(part 1 of 2)
# Autodesk Inventor assembly: Ensemble11
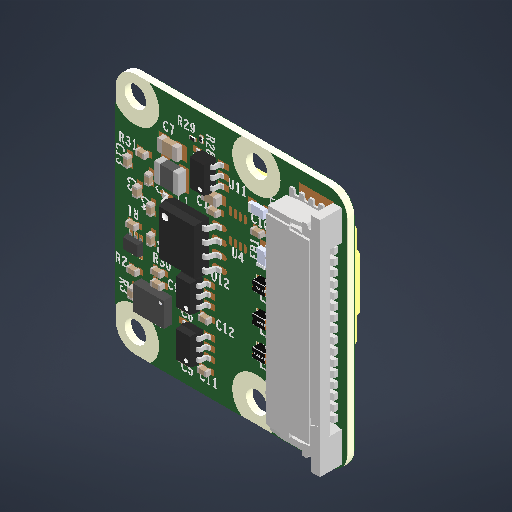
[picture p0: Inventor's stored thumbnail of the model, 512x512]
Saved by Autodesk Inventor 2026.2 (Build 302298010, 298A)
## iProperties
Created: 2026-11-11
Part Number: Ensemble11
Document SubType Name: Assembly
Designer: User
Author: User
## iProperties of the stored document RESC1005X40N_3.ipt
Created: 2026-11-11
Part Number: RESC1005X40N
Material: Générique
Description: PART--DESC
Document SubType Name: Modeling
Designer: User
Density: 1 g/cm^3
Appearance: Par défaut
Author: User
Revision Number: NONE
## iProperties of the stored document SOT95P280X145-5N_1.ipt
Created: 2026-11-11
Part Number: SOT95P280X145-5N
Material: Générique
Description: PART--DESC
Document SubType Name: Modeling
Designer: User
Density: 1 g/cm^3
Appearance: Par défaut
Author: User
Revision Number: NONE
## iProperties of the stored document MURATA_DLP11SNXXXHL2.ipt
Created: 2026-11-11
Part Number: MURATA_DLP11SNXXXHL2
Material: Générique
Description: PART--DESC
Document SubType Name: Modeling
Designer: User
Density: 1 g/cm^3
Appearance: Par défaut
Author: User
Revision Number: NONE
## iProperties of the stored document S2_1.ipt
Created: 2026-11-11
Part Number: S2
Material: Générique
Description: PART--DESC
Document SubType Name: Modeling
Designer: User
Density: 1 g/cm^3
Appearance: Par défaut
Author: User
Revision Number: NONE
## iProperties of the stored document NC1.ipt
Created: 2026-11-11
Part Number: NC1
Material: Générique
Description: PART--DESC
Document SubType Name: Modeling
Designer: User
Density: 1 g/cm^3
Appearance: Par défaut
Author: User
Revision Number: NONE
## iProperties of the stored document MECHANICAL PIN.ipt
Created: 2026-11-11
Part Number: MECHANICAL PIN
Material: Générique
Description: PART--DESC
Document SubType Name: Modeling
Designer: User
Density: 1 g/cm^3
Appearance: Par défaut
Author: User
Revision Number: NONE
## iProperties of the stored document 2_22.ipt
Created: 2026-11-11
Part Number: 2
Material: Générique
Description: PART--DESC
Document SubType Name: Modeling
Designer: User
Density: 1 g/cm^3
Appearance: Par défaut
Author: User
Revision Number: NONE
## iProperties of the stored document AFVDD.ipt
Created: 2026-11-11
Part Number: AFVDD
Material: Générique
Description: PART--DESC
Document SubType Name: Modeling
Designer: User
Density: 1 g/cm^3
Appearance: Par défaut
Author: User
Revision Number: NONE
## iProperties of the stored document 2_17.ipt
Created: 2026-11-11
Part Number: 2
Material: Générique
Description: PART--DESC
Document SubType Name: Modeling
Designer: User
Density: 1 g/cm^3
Appearance: Par défaut
Author: User
Revision Number: NONE
## iProperties of the stored document CAPC2012.ipt
Created: 2026-11-11
Part Number: CAPC2012
Material: Générique
Description: PART--DESC
Document SubType Name: Modeling
Designer: User
Density: 1 g/cm^3
Appearance: Par défaut
Author: User
Revision Number: NONE
## iProperties of the stored document 1_16.ipt
Created: 2026-11-11
Part Number: 1
Material: Générique
Description: PART--DESC
Document SubType Name: Modeling
Designer: User
Density: 1 g/cm^3
Appearance: Par défaut
Author: User
Revision Number: NONE
## iProperties of the stored document CAPC1005X55N.ipt
Created: 2026-11-11
Part Number: CAPC1005X55N
Material: Générique
Description: PART--DESC
Document SubType Name: Modeling
Designer: User
Density: 1 g/cm^3
Appearance: Par défaut
Author: User
Revision Number: NONE
## iProperties of the stored document 1_4.ipt
Created: 2026-11-11
Part Number: 1
Material: Générique
Description: PART--DESC
Document SubType Name: Modeling
Designer: User
Density: 1 g/cm^3
Appearance: Par défaut
Author: User
Revision Number: NONE
## iProperties of the stored document 1_10.ipt
Created: 2026-11-11
Part Number: 1
Material: Générique
Description: PART--DESC
Document SubType Name: Modeling
Designer: User
Density: 1 g/cm^3
Appearance: Par défaut
Author: User
Revision Number: NONE
## iProperties of the stored document 2.ipt
Created: 2026-11-11
Part Number: 2
Material: Générique
Description: PART--DESC
Document SubType Name: Modeling
Designer: User
Density: 1 g/cm^3
Appearance: Par défaut
Author: User
Revision Number: NONE
## iProperties of the stored document NC1_1.ipt
Created: 2026-11-11
Part Number: NC1
Material: Générique
Description: PART--DESC
Document SubType Name: Modeling
Designer: User
Density: 1 g/cm^3
Appearance: Par défaut
Author: User
Revision Number: NONE
## iProperties of the stored document NC2.ipt
Created: 2026-11-11
Part Number: NC2
Material: Générique
Description: PART--DESC
Document SubType Name: Modeling
Designer: User
Density: 1 g/cm^3
Appearance: Par défaut
Author: User
Revision Number: NONE
## iProperties of the stored document 15.ipt
Created: 2026-11-11
Part Number: 15
Material: Générique
Description: PART--DESC
Document SubType Name: Modeling
Designer: User
Density: 1 g/cm^3
Appearance: Par défaut
Author: User
Revision Number: NONE
## iProperties of the stored document 1_3.ipt
Created: 2026-11-11
Part Number: 1
Material: Générique
Description: PART--DESC
Document SubType Name: Modeling
Designer: User
Density: 1 g/cm^3
Appearance: Par défaut
Author: User
Revision Number: NONE
## iProperties of the stored document CAPC1608X90N.ipt
Created: 2026-11-11
Part Number: CAPC1608X90N
Material: Générique
Description: PART--DESC
Document SubType Name: Modeling
Designer: User
Density: 1 g/cm^3
Appearance: Par défaut
Author: User
Revision Number: NONE
## iProperties of the stored document CAPC1005X55N_4.ipt
Created: 2026-11-11
Part Number: CAPC1005X55N
Material: Générique
Description: PART--DESC
Document SubType Name: Modeling
Designer: User
Density: 1 g/cm^3
Appearance: Par défaut
Author: User
Revision Number: NONE
## iProperties of the stored document 1_5.ipt
Created: 2026-11-11
Part Number: 1
Material: Générique
Description: PART--DESC
Document SubType Name: Modeling
Designer: User
Density: 1 g/cm^3
Appearance: Par défaut
Author: User
Revision Number: NONE
## iProperties of the stored document MD1N.ipt
Created: 2026-11-11
Part Number: MD1N
Material: Générique
Description: PART--DESC
Document SubType Name: Modeling
Designer: User
Density: 1 g/cm^3
Appearance: Par défaut
Author: User
Revision Number: NONE
## iProperties of the stored document NC2_2.ipt
Created: 2026-11-11
Part Number: NC2
Material: Générique
Description: PART--DESC
Document SubType Name: Modeling
Designer: User
Density: 1 g/cm^3
Appearance: Par défaut
Author: User
Revision Number: NONE
## iProperties of the stored document P3.ipt
Created: 2026-11-11
Part Number: P3
Material: Générique
Description: PART--DESC
Document SubType Name: Modeling
Designer: User
Density: 1 g/cm^3
Appearance: Par défaut
Author: User
Revision Number: NONE
## iProperties of the stored document GND_2.ipt
Created: 2026-11-11
Part Number: GND
Material: Générique
Description: PART--DESC
Document SubType Name: Modeling
Designer: User
Density: 1 g/cm^3
Appearance: Par défaut
Author: User
Revision Number: NONE
## iProperties of the stored document DGND8.ipt
Created: 2026-11-11
Part Number: DGND8
Material: Générique
Description: PART--DESC
Document SubType Name: Modeling
Designer: User
Density: 1 g/cm^3
Appearance: Par défaut
Author: User
Revision Number: NONE
## iProperties of the stored document 2_1.ipt
Created: 2026-11-11
Part Number: 2
Material: Générique
Description: PART--DESC
Document SubType Name: Modeling
Designer: User
Density: 1 g/cm^3
Appearance: Par défaut
Author: User
Revision Number: NONE
## iProperties of the stored document 1_24.ipt
Created: 2026-11-11
Part Number: 1
Material: Générique
Description: PART--DESC
Document SubType Name: Modeling
Designer: User
Density: 1 g/cm^3
Appearance: Par défaut
Author: User
Revision Number: NONE
## iProperties of the stored document P1.ipt
Created: 2026-11-11
Part Number: P1
Material: Générique
Description: PART--DESC
Document SubType Name: Modeling
Designer: User
Density: 1 g/cm^3
Appearance: Par défaut
Author: User
Revision Number: NONE
## iProperties of the stored document DVDD_GPIO.ipt
Created: 2026-11-11
Part Number: DVDD/GPIO
Material: Générique
Description: PART--DESC
Document SubType Name: Modeling
Designer: User
Density: 1 g/cm^3
Appearance: Par défaut
Author: User
Revision Number: NONE
## iProperties of the stored document VCC.ipt
Created: 2026-11-11
Part Number: VCC
Material: Générique
Description: PART--DESC
Document SubType Name: Modeling
Designer: User
Density: 1 g/cm^3
Appearance: Par défaut
Author: User
Revision Number: NONE
## iProperties of the stored document EXP_PAD.ipt
Created: 2026-11-11
Part Number: EXP_PAD
Material: Générique
Description: PART--DESC
Document SubType Name: Modeling
Designer: User
Density: 1 g/cm^3
Appearance: Par défaut
Author: User
Revision Number: NONE
## iProperties of the stored document PG.ipt
Created: 2026-11-11
Part Number: PG
Material: Générique
Description: PART--DESC
Document SubType Name: Modeling
Designer: User
Density: 1 g/cm^3
Appearance: Par défaut
Author: User
Revision Number: NONE
## iProperties of the stored document VDD.ipt
Created: 2026-11-11
Part Number: VDD
Material: Générique
Description: PART--DESC
Document SubType Name: Modeling
Designer: User
Density: 1 g/cm^3
Appearance: Par défaut
Author: User
Revision Number: NONE
## iProperties of the stored document G2_1.ipt
Created: 2026-11-11
Part Number: G2
Material: Générique
Description: PART--DESC
Document SubType Name: Modeling
Designer: User
Density: 1 g/cm^3
Appearance: Par défaut
Author: User
Revision Number: NONE
## iProperties of the stored document GND_1.ipt
Created: 2026-11-11
Part Number: GND
Material: Générique
Description: PART--DESC
Document SubType Name: Modeling
Designer: User
Density: 1 g/cm^3
Appearance: Par défaut
Author: User
Revision Number: NONE
## iProperties of the stored document 12.ipt
Created: 2026-11-11
Part Number: 12
Material: Générique
Description: PART--DESC
Document SubType Name: Modeling
Designer: User
Density: 1 g/cm^3
Appearance: Par défaut
Author: User
Revision Number: NONE
## iProperties of the stored document CAPC1608X90N_1.ipt
Created: 2026-11-11
Part Number: CAPC1608X90N
Material: Générique
Description: PART--DESC
Document SubType Name: Modeling
Designer: User
Density: 1 g/cm^3
Appearance: Par défaut
Author: User
Revision Number: NONE
## iProperties of the stored document RESC1005X40N_4.ipt
Created: 2026-11-11
Part Number: RESC1005X40N
Material: Générique
Description: PART--DESC
Document SubType Name: Modeling
Designer: User
Density: 1 g/cm^3
Appearance: Par défaut
Author: User
Revision Number: NONE
## iProperties of the stored document 2_5.ipt
Created: 2026-11-11
Part Number: 2
Material: Générique
Description: PART--DESC
Document SubType Name: Modeling
Designer: User
Density: 1 g/cm^3
Appearance: Par défaut
Author: User
Revision Number: NONE
## iProperties of the stored document 1_22.ipt
Created: 2026-11-11
Part Number: 1
Material: Générique
Description: PART--DESC
Document SubType Name: Modeling
Designer: User
Density: 1 g/cm^3
Appearance: Par défaut
Author: User
Revision Number: NONE
## iProperties of the stored document G2.ipt
Created: 2026-11-11
Part Number: G2
Material: Générique
Description: PART--DESC
Document SubType Name: Modeling
Designer: User
Density: 1 g/cm^3
Appearance: Par défaut
Author: User
Revision Number: NONE
## iProperties of the stored document ATMEL_ATSHA204A_SOIC8.ipt
Created: 2026-11-11
Part Number: ATMEL_ATSHA204A_SOIC8
Material: Générique
Description: PART--DESC
Document SubType Name: Modeling
Designer: User
Density: 1 g/cm^3
Appearance: Par défaut
Author: User
Revision Number: NONE
## iProperties of the stored document MD1P.ipt
Created: 2026-11-11
Part Number: MD1P
Material: Générique
Description: PART--DESC
Document SubType Name: Modeling
Designer: User
Density: 1 g/cm^3
Appearance: Par défaut
Author: User
Revision Number: NONE
## iProperties of the stored document SCL.ipt
Created: 2026-11-11
Part Number: SCL
Material: Générique
Description: PART--DESC
Document SubType Name: Modeling
Designer: User
Density: 1 g/cm^3
Appearance: Par défaut
Author: User
Revision Number: NONE
## iProperties of the stored document 2_21.ipt
Created: 2026-11-11
Part Number: 2
Material: Générique
Description: PART--DESC
Document SubType Name: Modeling
Designer: User
Density: 1 g/cm^3
Appearance: Par défaut
Author: User
Revision Number: NONE
## iProperties of the stored document CAPC1005X55N_1.ipt
Created: 2026-11-11
Part Number: CAPC1005X55N
Material: Générique
Description: PART--DESC
Document SubType Name: Modeling
Designer: User
Density: 1 g/cm^3
Appearance: Par défaut
Author: User
Revision Number: NONE
## iProperties of the stored document SDA.ipt
Created: 2026-11-11
Part Number: SDA
Material: Générique
Description: PART--DESC
Document SubType Name: Modeling
Designer: User
Density: 1 g/cm^3
Appearance: Par défaut
Author: User
Revision Number: NONE
## iProperties of the stored document 1_7.ipt
Created: 2026-11-11
Part Number: 1
Material: Générique
Description: PART--DESC
Document SubType Name: Modeling
Designer: User
Density: 1 g/cm^3
Appearance: Par défaut
Author: User
Revision Number: NONE
## iProperties of the stored document 1_14.ipt
Created: 2026-11-11
Part Number: 1
Material: Générique
Description: PART--DESC
Document SubType Name: Modeling
Designer: User
Density: 1 g/cm^3
Appearance: Par défaut
Author: User
Revision Number: NONE
## iProperties of the stored document 2_23.ipt
Created: 2026-11-11
Part Number: 2
Material: Générique
Description: PART--DESC
Document SubType Name: Modeling
Designer: User
Density: 1 g/cm^3
Appearance: Par défaut
Author: User
Revision Number: NONE
## iProperties of the stored document 2_3.ipt
Created: 2026-11-11
Part Number: 2
Material: Générique
Description: PART--DESC
Document SubType Name: Modeling
Designer: User
Density: 1 g/cm^3
Appearance: Par défaut
Author: User
Revision Number: NONE
## iProperties of the stored document 1.ipt
Created: 2026-11-11
Part Number: 1
Material: Générique
Description: PART--DESC
Document SubType Name: Modeling
Designer: User
Density: 1 g/cm^3
Appearance: Par défaut
Author: User
Revision Number: NONE
## iProperties of the stored document LX.ipt
Created: 2026-11-11
Part Number: LX
Material: Générique
Description: PART--DESC
Document SubType Name: Modeling
Designer: User
Density: 1 g/cm^3
Appearance: Par défaut
Author: User
Revision Number: NONE
## iProperties of the stored document P4_2.ipt
Created: 2026-11-11
Part Number: P4
Material: Générique
Description: PART--DESC
Document SubType Name: Modeling
Designer: User
Density: 1 g/cm^3
Appearance: Par défaut
Author: User
Revision Number: NONE
## iProperties of the stored document 8.ipt
Created: 2026-11-11
Part Number: 8
Material: Générique
Description: PART--DESC
Document SubType Name: Modeling
Designer: User
Density: 1 g/cm^3
Appearance: Par défaut
Author: User
Revision Number: NONE
## iProperties of the stored document MCKP.ipt
Created: 2026-11-11
Part Number: MCKP
Material: Générique
Description: PART--DESC
Document SubType Name: Modeling
Designer: User
Density: 1 g/cm^3
Appearance: Par défaut
Author: User
Revision Number: NONE
## iProperties of the stored document DVDD.ipt
Created: 2026-11-11
Part Number: DVDD
Material: Générique
Description: PART--DESC
Document SubType Name: Modeling
Designer: User
Density: 1 g/cm^3
Appearance: Par défaut
Author: User
Revision Number: NONE
## iProperties of the stored document VO1V8.ipt
Created: 2026-11-11
Part Number: VO1V8
Material: Générique
Description: PART--DESC
Document SubType Name: Modeling
Designer: User
Density: 1 g/cm^3
Appearance: Par défaut
Author: User
Revision Number: NONE
## iProperties of the stored document ATMEL_ATSHA204A_8UDFN.ipt
Created: 2026-11-11
Part Number: ATMEL_ATSHA204A_8UDFN
Material: Générique
Description: PART--DESC
Document SubType Name: Modeling
Designer: User
Density: 1 g/cm^3
Appearance: Par défaut
Author: User
Revision Number: NONE
## iProperties of the stored document DGND3.ipt
Created: 2026-11-11
Part Number: DGND3
Material: Générique
Description: PART--DESC
Document SubType Name: Modeling
Designer: User
Density: 1 g/cm^3
Appearance: Par défaut
Author: User
Revision Number: NONE
## iProperties of the stored document 7.ipt
Created: 2026-11-11
Part Number: 7
Material: Générique
Description: PART--DESC
Document SubType Name: Modeling
Designer: User
Density: 1 g/cm^3
Appearance: Par défaut
Author: User
Revision Number: NONE
## iProperties of the stored document D2_1.ipt
Created: 2026-11-11
Part Number: D2
Material: Générique
Description: PART--DESC
Document SubType Name: Modeling
Designer: User
Density: 1 g/cm^3
Appearance: Par défaut
Author: User
Revision Number: NONE
## iProperties of the stored document 1_2.ipt
Created: 2026-11-11
Part Number: 1
Material: Générique
Description: PART--DESC
Document SubType Name: Modeling
Designer: User
Density: 1 g/cm^3
Appearance: Par défaut
Author: User
Revision Number: NONE
## iProperties of the stored document _PWDN.ipt
Created: 2026-11-11
Part Number: /PWDN
Material: Générique
Description: PART-/PWDN-DESC
Document SubType Name: Modeling
Designer: User
Density: 1 g/cm^3
Appearance: Par défaut
Author: User
Revision Number: NONE
## iProperties of the stored document 1_1.ipt
Created: 2026-11-11
Part Number: 1
Material: Générique
Description: PART--DESC
Document SubType Name: Modeling
Designer: User
Density: 1 g/cm^3
Appearance: Par défaut
Author: User
Revision Number: NONE
## iProperties of the stored document OUTPUT.ipt
Created: 2026-11-11
Part Number: OUTPUT
Material: Générique
Description: PART--DESC
Document SubType Name: Modeling
Designer: User
Density: 1 g/cm^3
Appearance: Par défaut
Author: User
Revision Number: NONE
## iProperties of the stored document CAPC1005X55N_2.ipt
Created: 2026-11-11
Part Number: CAPC1005X55N
Material: Générique
Description: PART--DESC
Document SubType Name: Modeling
Designer: User
Density: 1 g/cm^3
Appearance: Par défaut
Author: User
Revision Number: NONE
## iProperties of the stored document CAPC1005X55N_5.ipt
Created: 2026-11-11
Part Number: CAPC1005X55N
Material: Générique
Description: PART--DESC
Document SubType Name: Modeling
Designer: User
Density: 1 g/cm^3
Appearance: Par défaut
Author: User
Revision Number: NONE
## iProperties of the stored document EN_1.ipt
Created: 2026-11-11
Part Number: EN
Material: Générique
Description: PART--DESC
Document SubType Name: Modeling
Designer: User
Density: 1 g/cm^3
Appearance: Par défaut
Author: User
Revision Number: NONE
## iProperties of the stored document 2_9.ipt
Created: 2026-11-11
Part Number: 2
Material: Générique
Description: PART--DESC
Document SubType Name: Modeling
Designer: User
Density: 1 g/cm^3
Appearance: Par défaut
Author: User
Revision Number: NONE
## iProperties of the stored document OE.ipt
Created: 2026-11-11
Part Number: OE
Material: Générique
Description: PART--DESC
Document SubType Name: Modeling
Designer: User
Density: 1 g/cm^3
Appearance: Par défaut
Author: User
Revision Number: NONE
## iProperties of the stored document MURATA_DLP11SNXXXHL2_2.ipt
Created: 2026-11-11
Part Number: MURATA_DLP11SNXXXHL2
Material: Générique
Description: PART--DESC
Document SubType Name: Modeling
Designer: User
Density: 1 g/cm^3
Appearance: Par défaut
Author: User
Revision Number: NONE
## iProperties of the stored document P2.ipt
Created: 2026-11-11
Part Number: P2
Material: Générique
Description: PART--DESC
Document SubType Name: Modeling
Designer: User
Density: 1 g/cm^3
Appearance: Par défaut
Author: User
Revision Number: NONE
## iProperties of the stored document NC2_1.ipt
Created: 2026-11-11
Part Number: NC2
Material: Générique
Description: PART--DESC
Document SubType Name: Modeling
Designer: User
Density: 1 g/cm^3
Appearance: Par défaut
Author: User
Revision Number: NONE
## iProperties of the stored document Shapes.iam
Created: 2026-11-11
Part Number: Shapes
Description: PART--DESC
Document SubType Name: Assembly
Designer: User
Author: User
Revision Number: NONE
## iProperties of the stored document GND_6.ipt
Created: 2026-11-11
Part Number: GND
Material: Générique
Description: PART--DESC
Document SubType Name: Modeling
Designer: User
Density: 1 g/cm^3
Appearance: Par défaut
Author: User
Revision Number: NONE
## iProperties of the stored document RESC1005X40N_1.ipt
Created: 2026-11-11
Part Number: RESC1005X40N
Material: Générique
Description: PART--DESC
Document SubType Name: Modeling
Designer: User
Density: 1 g/cm^3
Appearance: Par défaut
Author: User
Revision Number: NONE
## iProperties of the stored document P4.ipt
Created: 2026-11-11
Part Number: P4
Material: Générique
Description: PART--DESC
Document SubType Name: Modeling
Designer: User
Density: 1 g/cm^3
Appearance: Par défaut
Author: User
Revision Number: NONE
## iProperties of the stored document NC3.ipt
Created: 2026-11-11
Part Number: NC3
Material: Générique
Description: PART--DESC
Document SubType Name: Modeling
Designer: User
Density: 1 g/cm^3
Appearance: Par défaut
Author: User
Revision Number: NONE
## iProperties of the stored document MECHANICAL PIN_2.ipt
Created: 2026-11-11
Part Number: MECHANICAL PIN
Material: Générique
Description: PART--DESC
Document SubType Name: Modeling
Designer: User
Density: 1 g/cm^3
Appearance: Par défaut
Author: User
Revision Number: NONE
## iProperties of the stored document NC6.ipt
Created: 2026-11-11
Part Number: NC6
Material: Générique
Description: PART--DESC
Document SubType Name: Modeling
Designer: User
Density: 1 g/cm^3
Appearance: Par défaut
Author: User
Revision Number: NONE
## iProperties of the stored document GND_3.ipt
Created: 2026-11-11
Part Number: GND
Material: Générique
Description: PART--DESC
Document SubType Name: Modeling
Designer: User
Density: 1 g/cm^3
Appearance: Par défaut
Author: User
Revision Number: NONE
## iProperties of the stored document DGND6.ipt
Created: 2026-11-11
Part Number: DGND6
Material: Générique
Description: PART--DESC
Document SubType Name: Modeling
Designer: User
Density: 1 g/cm^3
Appearance: Par défaut
Author: User
Revision Number: NONE
## iProperties of the stored document SILKSCREEN_BOTTOM.ipt
Created: 2026-11-11
Part Number: SILKSCREEN_BOTTOM
Material: Générique
Description: PART--DESC
Document SubType Name: Modeling
Designer: User
Density: 1 g/cm^3
Appearance: Par défaut
Author: User
Revision Number: NONE
## iProperties of the stored document P4_1.ipt
Created: 2026-11-11
Part Number: P4
Material: Générique
Description: PART--DESC
Document SubType Name: Modeling
Designer: User
Density: 1 g/cm^3
Appearance: Par défaut
Author: User
Revision Number: NONE
## iProperties of the stored document 2_14.ipt
Created: 2026-11-11
Part Number: 2
Material: Générique
Description: PART--DESC
Document SubType Name: Modeling
Designer: User
Density: 1 g/cm^3
Appearance: Par défaut
Author: User
Revision Number: NONE
## iProperties of the stored document FCI_SFW15R-1STE1LF.ipt
Created: 2026-11-11
Part Number: FCI_SFW15R-1STE1LF
Material: Générique
Description: PART--DESC
Document SubType Name: Modeling
Designer: User
Density: 1 g/cm^3
Appearance: Par défaut
Author: User
Revision Number: NONE
## iProperties of the stored document 1_23.ipt
Created: 2026-11-11
Part Number: 1
Material: Générique
Description: PART--DESC
Document SubType Name: Modeling
Designer: User
Density: 1 g/cm^3
Appearance: Par défaut
Author: User
Revision Number: NONE
## iProperties of the stored document P3_2.ipt
Created: 2026-11-11
Part Number: P3
Material: Générique
Description: PART--DESC
Document SubType Name: Modeling
Designer: User
Density: 1 g/cm^3
Appearance: Par défaut
Author: User
Revision Number: NONE
## iProperties of the stored document CAPC1005X55N_8.ipt
Created: 2026-11-11
Part Number: CAPC1005X55N
Material: Générique
Description: PART--DESC
Document SubType Name: Modeling
Designer: User
Density: 1 g/cm^3
Appearance: Par défaut
Author: User
Revision Number: NONE
## iProperties of the stored document CAPC1608.ipt
Created: 2026-11-11
Part Number: CAPC1608
Material: Générique
Description: PART--DESC
Document SubType Name: Modeling
Designer: User
Density: 1 g/cm^3
Appearance: Par défaut
Author: User
Revision Number: NONE
## iProperties of the stored document 5.ipt
Created: 2026-11-11
Part Number: 5
Material: Générique
Description: PART--DESC
Document SubType Name: Modeling
Designer: User
Density: 1 g/cm^3
Appearance: Par défaut
Author: User
Revision Number: NONE
## iProperties of the stored document RESC0603.ipt
Created: 2026-11-11
Part Number: RESC0603
Material: Générique
Description: PART--DESC
Document SubType Name: Modeling
Designer: User
Density: 1 g/cm^3
Appearance: Par défaut
Author: User
Revision Number: NONE
## iProperties of the stored document GND_5.ipt
Created: 2026-11-11
Part Number: GND
Material: Générique
Description: PART--DESC
Document SubType Name: Modeling
Designer: User
Density: 1 g/cm^3
Appearance: Par défaut
Author: User
Revision Number: NONE
## iProperties of the stored document 1_15.ipt
Created: 2026-11-11
Part Number: 1
Material: Générique
Description: PART--DESC
Document SubType Name: Modeling
Designer: User
Density: 1 g/cm^3
Appearance: Par défaut
Author: User
Revision Number: NONE
## iProperties of the stored document Pins.iam
Created: 2026-11-11
Part Number: Pins
Description: PART--DESC
Document SubType Name: Assembly
Designer: User
Author: User
Revision Number: NONE
## iProperties of the stored document 2_16.ipt
Created: 2026-11-11
Part Number: 2
Material: Générique
Description: PART--DESC
Document SubType Name: Modeling
Designer: User
Density: 1 g/cm^3
Appearance: Par défaut
Author: User
Revision Number: NONE
## iProperties of the stored document 9.ipt
Created: 2026-11-11
Part Number: 9
Material: Générique
Description: PART--DESC
Document SubType Name: Modeling
Designer: User
Density: 1 g/cm^3
Appearance: Par défaut
Author: User
Revision Number: NONE
## iProperties of the stored document OUT_1.ipt
Created: 2026-11-11
Part Number: OUT
Material: Générique
Description: PART--DESC
Document SubType Name: Modeling
Designer: User
Density: 1 g/cm^3
Appearance: Par défaut
Author: User
Revision Number: NONE
## iProperties of the stored document 3.ipt
Created: 2026-11-11
Part Number: 3
Material: Générique
Description: PART--DESC
Document SubType Name: Modeling
Designer: User
Density: 1 g/cm^3
Appearance: Par défaut
Author: User
Revision Number: NONE
## iProperties of the stored document MECHANICAL PIN_1.ipt
Created: 2026-11-11
Part Number: MECHANICAL PIN
Material: Générique
Description: PART--DESC
Document SubType Name: Modeling
Designer: User
Density: 1 g/cm^3
Appearance: Par défaut
Author: User
Revision Number: NONE
## iProperties of the stored document 2_8.ipt
Created: 2026-11-11
Part Number: 2
Material: Générique
Description: PART--DESC
Document SubType Name: Modeling
Designer: User
Density: 1 g/cm^3
Appearance: Par défaut
Author: User
Revision Number: NONE
## iProperties of the stored document 2_2.ipt
Created: 2026-11-11
Part Number: 2
Material: Générique
Description: PART--DESC
Document SubType Name: Modeling
Designer: User
Density: 1 g/cm^3
Appearance: Par défaut
Author: User
Revision Number: NONE
## iProperties of the stored document 2_7.ipt
Created: 2026-11-11
Part Number: 2
Material: Générique
Description: PART--DESC
Document SubType Name: Modeling
Designer: User
Density: 1 g/cm^3
Appearance: Par défaut
Author: User
Revision Number: NONE
## iProperties of the stored document PASTEMASK_TOP.ipt
Created: 2026-11-11
Part Number: PASTEMASK_TOP
Material: Générique
Description: PART--DESC
Document SubType Name: Modeling
Designer: User
Density: 1 g/cm^3
Appearance: Par défaut
Author: User
Revision Number: NONE
## iProperties of the stored document NC7.ipt
Created: 2026-11-11
Part Number: NC7
Material: Générique
Description: PART--DESC
Document SubType Name: Modeling
Designer: User
Density: 1 g/cm^3
Appearance: Par défaut
Author: User
Revision Number: NONE
## iProperties of the stored document CAPC1005X55N_11.ipt
Created: 2026-11-11
Part Number: CAPC1005X55N
Material: Générique
Description: PART--DESC
Document SubType Name: Modeling
Designer: User
Density: 1 g/cm^3
Appearance: Par défaut
Author: User
Revision Number: NONE
## iProperties of the stored document GND.ipt
Created: 2026-11-11
Part Number: GND
Material: Générique
Description: PART--DESC
Document SubType Name: Modeling
Designer: User
Density: 1 g/cm^3
Appearance: Par défaut
Author: User
Revision Number: NONE
## iProperties of the stored document FB.ipt
Created: 2026-11-11
Part Number: FB
Material: Générique
Description: PART--DESC
Document SubType Name: Modeling
Designer: User
Density: 1 g/cm^3
Appearance: Par défaut
Author: User
Revision Number: NONE
## iProperties of the stored document 10.ipt
Created: 2026-11-11
Part Number: 10
Material: Générique
Description: PART--DESC
Document SubType Name: Modeling
Designer: User
Density: 1 g/cm^3
Appearance: Par défaut
Author: User
Revision Number: NONE
## iProperties of the stored document SOT50P160X60-6N.ipt
Created: 2026-11-11
Part Number: SOT50P160X60-6N
Material: Générique
Description: PART--DESC
Document SubType Name: Modeling
Designer: User
Density: 1 g/cm^3
Appearance: Par défaut
Author: User
Revision Number: NONE
## iProperties of the stored document BOURNS_SRN2512.ipt
Created: 2026-11-11
Part Number: BOURNS_SRN2512
Material: Générique
Description: PART--DESC
Document SubType Name: Modeling
Designer: User
Density: 1 g/cm^3
Appearance: Par défaut
Author: User
Revision Number: NONE
## iProperties of the stored document VIN.ipt
Created: 2026-11-11
Part Number: VIN
Material: Générique
Description: PART--DESC
Document SubType Name: Modeling
Designer: User
Density: 1 g/cm^3
Appearance: Par défaut
Author: User
Revision Number: NONE
## iProperties of the stored document PASTEMASK_BOTTOM.ipt
Created: 2026-11-11
Part Number: PASTEMASK_BOTTOM
Material: Générique
Description: PART--DESC
Document SubType Name: Modeling
Designer: User
Density: 1 g/cm^3
Appearance: Par défaut
Author: User
Revision Number: NONE
## iProperties of the stored document NC_1.ipt
Created: 2026-11-11
Part Number: NC
Material: Générique
Description: PART--DESC
Document SubType Name: Modeling
Designer: User
Density: 1 g/cm^3
Appearance: Par défaut
Author: User
Revision Number: NONE
## iProperties of the stored document 2_20.ipt
Created: 2026-11-11
Part Number: 2
Material: Générique
Description: PART--DESC
Document SubType Name: Modeling
Designer: User
Density: 1 g/cm^3
Appearance: Par défaut
Author: User
Revision Number: NONE
## iProperties of the stored document SCL_1.ipt
Created: 2026-11-11
Part Number: SCL
Material: Générique
Description: PART--DESC
Document SubType Name: Modeling
Designer: User
Density: 1 g/cm^3
Appearance: Par défaut
Author: User
Revision Number: NONE
## iProperties of the stored document DGND1.ipt
Created: 2026-11-11
Part Number: DGND1
Material: Générique
Description: PART--DESC
Document SubType Name: Modeling
Designer: User
Density: 1 g/cm^3
Appearance: Par défaut
Author: User
Revision Number: NONE
## iProperties of the stored document GND_4.ipt
Created: 2026-11-11
Part Number: GND
Material: Générique
Description: PART--DESC
Document SubType Name: Modeling
Designer: User
Density: 1 g/cm^3
Appearance: Par défaut
Author: User
Revision Number: NONE
## iProperties of the stored document CAPC1005X55N_10.ipt
Created: 2026-11-11
Part Number: CAPC1005X55N
Material: Générique
Description: PART--DESC
Document SubType Name: Modeling
Designer: User
Density: 1 g/cm^3
Appearance: Par défaut
Author: User
Revision Number: NONE
## iProperties of the stored document CAPC1005X55N_6.ipt
Created: 2026-11-11
Part Number: CAPC1005X55N
Material: Générique
Description: PART--DESC
Document SubType Name: Modeling
Designer: User
Density: 1 g/cm^3
Appearance: Par défaut
Author: User
Revision Number: NONE
## iProperties of the stored document VCC_1.ipt
Created: 2026-11-11
Part Number: VCC
Material: Générique
Description: PART--DESC
Document SubType Name: Modeling
Designer: User
Density: 1 g/cm^3
Appearance: Par défaut
Author: User
Revision Number: NONE
## iProperties of the stored document AGND.ipt
Created: 2026-11-11
Part Number: AGND
Material: Générique
Description: PART--DESC
Document SubType Name: Modeling
Designer: User
Density: 1 g/cm^3
Appearance: Par défaut
Author: User
Revision Number: NONE
## iProperties of the stored document MCLK.ipt
Created: 2026-11-11
Part Number: MCLK
Material: Générique
Description: PART--DESC
Document SubType Name: Modeling
Designer: User
Density: 1 g/cm^3
Appearance: Par défaut
Author: User
Revision Number: NONE
## iProperties of the stored document 1_17.ipt
Created: 2026-11-11
Part Number: 1
Material: Générique
Description: PART--DESC
Document SubType Name: Modeling
Designer: User
Density: 1 g/cm^3
Appearance: Par défaut
Author: User
Revision Number: NONE
## iProperties of the stored document P3_1.ipt
Created: 2026-11-11
Part Number: P3
Material: Générique
Description: PART--DESC
Document SubType Name: Modeling
Designer: User
Density: 1 g/cm^3
Appearance: Par défaut
Author: User
Revision Number: NONE
## iProperties of the stored document Symbols.iam
Created: 2026-11-11
Part Number: Symbols
Description: PART--DESC
Document SubType Name: Assembly
Designer: User
Author: User
Revision Number: NONE
## iProperties of the stored document EN_2.ipt
Created: 2026-11-11
Part Number: EN
Material: Générique
Description: PART--DESC
Document SubType Name: Modeling
Designer: User
Density: 1 g/cm^3
Appearance: Par défaut
Author: User
Revision Number: NONE
## iProperties of the stored document MD0P.ipt
Created: 2026-11-11
Part Number: MD0P
Material: Générique
Description: PART--DESC
Document SubType Name: Modeling
Designer: User
Density: 1 g/cm^3
Appearance: Par défaut
Author: User
Revision Number: NONE
## iProperties of the stored document CAPC1005X55N_3.ipt
Created: 2026-11-11
Part Number: CAPC1005X55N
Material: Générique
Description: PART--DESC
Document SubType Name: Modeling
Designer: User
Density: 1 g/cm^3
Appearance: Par défaut
Author: User
Revision Number: NONE
## iProperties of the stored document MECHANICAL PIN_4.ipt
Created: 2026-11-11
Part Number: MECHANICAL PIN
Material: Générique
Description: PART--DESC
Document SubType Name: Modeling
Designer: User
Density: 1 g/cm^3
Appearance: Par défaut
Author: User
Revision Number: NONE
## iProperties of the stored document MD0N.ipt
Created: 2026-11-11
Part Number: MD0N
Material: Générique
Description: PART--DESC
Document SubType Name: Modeling
Designer: User
Density: 1 g/cm^3
Appearance: Par défaut
Author: User
Revision Number: NONE
## iProperties of the stored document SOLDERMASK_TOP.ipt
Created: 2026-11-11
Part Number: SOLDERMASK_TOP
Material: Générique
Description: PART--DESC
Document SubType Name: Modeling
Designer: User
Density: 1 g/cm^3
Appearance: Par défaut
Author: User
Revision Number: NONE
## iProperties of the stored document 2_15.ipt
Created: 2026-11-11
Part Number: 2
Material: Générique
Description: PART--DESC
Document SubType Name: Modeling
Designer: User
Density: 1 g/cm^3
Appearance: Par défaut
Author: User
Revision Number: NONE
## iProperties of the stored document DGND7.ipt
Created: 2026-11-11
Part Number: DGND7
Material: Générique
Description: PART--DESC
Document SubType Name: Modeling
Designer: User
Density: 1 g/cm^3
Appearance: Par défaut
Author: User
Revision Number: NONE
## iProperties of the stored document 1_18.ipt
Created: 2026-11-11
Part Number: 1
Material: Générique
Description: PART--DESC
Document SubType Name: Modeling
Designer: User
Density: 1 g/cm^3
Appearance: Par défaut
Author: User
Revision Number: NONE
## iProperties of the stored document SILKSCREEN_TOP.ipt
Created: 2026-11-11
Part Number: SILKSCREEN_TOP
Material: Générique
Description: PART-SILKSCREEN_TOP-DESC
Document SubType Name: Modeling
Designer: User
Density: 1 g/cm^3
Appearance: Par défaut
Author: User
Revision Number: NONE
## iProperties of the stored document 1_12.ipt
Created: 2026-11-11
Part Number: 1
Material: Générique
Description: PART--DESC
Document SubType Name: Modeling
Designer: User
Density: 1 g/cm^3
Appearance: Par défaut
Author: User
Revision Number: NONE
## iProperties of the stored document RESC0603_1.ipt
Created: 2026-11-11
Part Number: RESC0603
Material: Générique
Description: PART--DESC
Document SubType Name: Modeling
Designer: User
Density: 1 g/cm^3
Appearance: Par défaut
Author: User
Revision Number: NONE
## iProperties of the stored document NC.ipt
Created: 2026-11-11
Part Number: NC
Material: Générique
Description: PART--DESC
Document SubType Name: Modeling
Designer: User
Density: 1 g/cm^3
Appearance: Par défaut
Author: User
Revision Number: NONE
## iProperties of the stored document VA2V8.ipt
Created: 2026-11-11
Part Number: VA2V8
Material: Générique
Description: PART--DESC
Document SubType Name: Modeling
Designer: User
Density: 1 g/cm^3
Appearance: Par défaut
Author: User
Revision Number: NONE
## iProperties of the stored document 2_6.ipt
Created: 2026-11-11
Part Number: 2
Material: Générique
Description: PART--DESC
Document SubType Name: Modeling
Designer: User
Density: 1 g/cm^3
Appearance: Par défaut
Author: User
Revision Number: NONE
## iProperties of the stored document 1_11.ipt
Created: 2026-11-11
Part Number: 1
Material: Générique
Description: PART--DESC
Document SubType Name: Modeling
Designer: User
Density: 1 g/cm^3
Appearance: Par défaut
Author: User
Revision Number: NONE
## iProperties of the stored document 4.ipt
Created: 2026-11-11
Part Number: 4
Material: Générique
Description: PART--DESC
Document SubType Name: Modeling
Designer: User
Density: 1 g/cm^3
Appearance: Par défaut
Author: User
Revision Number: NONE
## iProperties of the stored document SOLDERMASK_BOTTOM.ipt
Created: 2026-11-11
Part Number: SOLDERMASK_BOTTOM
Material: Générique
Description: PART--DESC
Document SubType Name: Modeling
Designer: User
Density: 1 g/cm^3
Appearance: Par défaut
Author: User
Revision Number: NONE
## iProperties of the stored document AP3445.ipt
Created: 2026-11-11
Part Number: AP3445
Material: Générique
Description: PART-AP3445-DESC
Document SubType Name: Modeling
Designer: User
Density: 1 g/cm^3
Appearance: Par défaut
Author: User
Revision Number: NONE
## iProperties of the stored document 2_10.ipt
Created: 2026-11-11
Part Number: 2
Material: Générique
Description: PART--DESC
Document SubType Name: Modeling
Designer: User
Density: 1 g/cm^3
Appearance: Par défaut
Author: User
Revision Number: NONE
## iProperties of the stored document 2_4.ipt
Created: 2026-11-11
Part Number: 2
Material: Générique
Description: PART--DESC
Document SubType Name: Modeling
Designer: User
Density: 1 g/cm^3
Appearance: Par défaut
Author: User
Revision Number: NONE
## iProperties of the stored document NC1_2.ipt
Created: 2026-11-11
Part Number: NC1
Material: Générique
Description: PART--DESC
Document SubType Name: Modeling
Designer: User
Density: 1 g/cm^3
Appearance: Par défaut
Author: User
Revision Number: NONE
## iProperties of the stored document HIROSE_DF37NC-30DS-04V.ipt
Created: 2026-11-11
Part Number: HIROSE_DF37NC-30DS-04V
Material: Générique
Description: PART--DESC
Document SubType Name: Modeling
Designer: User
Density: 1 g/cm^3
Appearance: Par défaut
Author: User
Revision Number: NONE
## iProperties of the stored document 2_13.ipt
Created: 2026-11-11
Part Number: 2
Material: Générique
Description: PART--DESC
Document SubType Name: Modeling
Designer: User
Density: 1 g/cm^3
Appearance: Par défaut
Author: User
Revision Number: NONE
## iProperties of the stored document 2_24.ipt
Created: 2026-11-11
Part Number: 2
Material: Générique
Description: PART--DESC
Document SubType Name: Modeling
Designer: User
Density: 1 g/cm^3
Appearance: Par défaut
Author: User
Revision Number: NONE
## iProperties of the stored document 6.ipt
Created: 2026-11-11
Part Number: 6
Material: Générique
Description: PART--DESC
Document SubType Name: Modeling
Designer: User
Density: 1 g/cm^3
Appearance: Par défaut
Author: User
Revision Number: NONE
## iProperties of the stored document DGND9.ipt
Created: 2026-11-11
Part Number: DGND9
Material: Générique
Description: PART--DESC
Document SubType Name: Modeling
Designer: User
Density: 1 g/cm^3
Appearance: Par défaut
Author: User
Revision Number: NONE
## iProperties of the stored document OSC_2P5X2MM.ipt
Created: 2026-11-11
Part Number: OSC_2P5X2MM
Material: Générique
Description: PART--DESC
Document SubType Name: Modeling
Designer: User
Density: 1 g/cm^3
Appearance: Par défaut
Author: User
Revision Number: NONE
## iProperties of the stored document RESC1005X40N_2.ipt
Created: 2026-11-11
Part Number: RESC1005X40N
Material: Générique
Description: PART--DESC
Document SubType Name: Modeling
Designer: User
Density: 1 g/cm^3
Appearance: Par défaut
Author: User
Revision Number: NONE
## iProperties of the stored document SOT95P280X145-5N.ipt
Created: 2026-11-11
Part Number: SOT95P280X145-5N
Material: Générique
Description: PART--DESC
Document SubType Name: Modeling
Designer: User
Density: 1 g/cm^3
Appearance: Par défaut
Author: User
Revision Number: NONE
## iProperties of the stored document SCL_2.ipt
Created: 2026-11-11
Part Number: SCL
Material: Générique
Description: PART--DESC
Document SubType Name: Modeling
Designer: User
Density: 1 g/cm^3
Appearance: Par défaut
Author: User
Revision Number: NONE
## iProperties of the stored document CAPC1005X55N_9.ipt
Created: 2026-11-11
Part Number: CAPC1005X55N
Material: Générique
Description: PART--DESC
Document SubType Name: Modeling
Designer: User
Density: 1 g/cm^3
Appearance: Par défaut
Author: User
Revision Number: NONE
## iProperties of the stored document 2_19.ipt
Created: 2026-11-11
Part Number: 2
Material: Générique
Description: PART--DESC
Document SubType Name: Modeling
Designer: User
Density: 1 g/cm^3
Appearance: Par défaut
Author: User
Revision Number: NONE
## iProperties of the stored document EN.ipt
Created: 2026-11-11
Part Number: EN
Material: Générique
Description: PART--DESC
Document SubType Name: Modeling
Designer: User
Density: 1 g/cm^3
Appearance: Par défaut
Author: User
Revision Number: NONE
## iProperties of the stored document 2_12.ipt
Created: 2026-11-11
Part Number: 2
Material: Générique
Description: PART--DESC
Document SubType Name: Modeling
Designer: User
Density: 1 g/cm^3
Appearance: Par défaut
Author: User
Revision Number: NONE
## iProperties of the stored document OUT.ipt
Created: 2026-11-11
Part Number: OUT
Material: Générique
Description: PART--DESC
Document SubType Name: Modeling
Designer: User
Density: 1 g/cm^3
Appearance: Par défaut
Author: User
Revision Number: NONE
## iProperties of the stored document DGND5.ipt
Created: 2026-11-11
Part Number: DGND5
Material: Générique
Description: PART--DESC
Document SubType Name: Modeling
Designer: User
Density: 1 g/cm^3
Appearance: Par défaut
Author: User
Revision Number: NONE
## iProperties of the stored document NC4.ipt
Created: 2026-11-11
Part Number: NC4
Material: Générique
Description: PART--DESC
Document SubType Name: Modeling
Designer: User
Density: 1 g/cm^3
Appearance: Par défaut
Author: User
Revision Number: NONE
## iProperties of the stored document 11.ipt
Created: 2026-11-11
Part Number: 11
Material: Générique
Description: PART--DESC
Document SubType Name: Modeling
Designer: User
Density: 1 g/cm^3
Appearance: Par défaut
Author: User
Revision Number: NONE
## iProperties of the stored document IN_1.ipt
Created: 2026-11-11
Part Number: IN
Material: Générique
Description: PART--DESC
Document SubType Name: Modeling
Designer: User
Density: 1 g/cm^3
Appearance: Par défaut
Author: User
Revision Number: NONE
## iProperties of the stored document CAPC1005X55N_7.ipt
Created: 2026-11-11
Part Number: CAPC1005X55N
Material: Générique
Description: PART--DESC
Document SubType Name: Modeling
Designer: User
Density: 1 g/cm^3
Appearance: Par défaut
Author: User
Revision Number: NONE
## iProperties of the stored document NC7_1.ipt
Created: 2026-11-11
Part Number: NC7
Material: Générique
Description: PART--DESC
Document SubType Name: Modeling
Designer: User
Density: 1 g/cm^3
Appearance: Par défaut
Author: User
Revision Number: NONE
## iProperties of the stored document S2.ipt
Created: 2026-11-11
Part Number: S2
Material: Générique
Description: PART--DESC
Document SubType Name: Modeling
Designer: User
Density: 1 g/cm^3
Appearance: Par défaut
Author: User
Revision Number: NONE
## iProperties of the stored document DGND4.ipt
Created: 2026-11-11
Part Number: DGND4
Material: Générique
Description: PART--DESC
Document SubType Name: Modeling
Designer: User
Density: 1 g/cm^3
Appearance: Par défaut
Author: User
Revision Number: NONE
## iProperties of the stored document 1_9.ipt
Created: 2026-11-11
Part Number: 1
Material: Générique
Description: PART--DESC
Document SubType Name: Modeling
Designer: User
Density: 1 g/cm^3
Appearance: Par défaut
Author: User
Revision Number: NONE
## iProperties of the stored document P1_1.ipt
Created: 2026-11-11
Part Number: P1
Material: Générique
Description: PART--DESC
Document SubType Name: Modeling
Designer: User
Density: 1 g/cm^3
Appearance: Par défaut
Author: User
Revision Number: NONE
## iProperties of the stored document MCKN.ipt
Created: 2026-11-11
Part Number: MCKN
Material: Générique
Description: PART--DESC
Document SubType Name: Modeling
Designer: User
Density: 1 g/cm^3
Appearance: Par défaut
Author: User
Revision Number: NONE
## iProperties of the stored document 13.ipt
Created: 2026-11-11
Part Number: 13
Material: Générique
Description: PART--DESC
Document SubType Name: Modeling
Designer: User
Density: 1 g/cm^3
Appearance: Par défaut
Author: User
Revision Number: NONE
## iProperties of the stored document RESC1005X40N.ipt
Created: 2026-11-11
Part Number: RESC1005X40N
Material: Générique
Description: PART--DESC
Document SubType Name: Modeling
Designer: User
Density: 1 g/cm^3
Appearance: Par défaut
Author: User
Revision Number: NONE
## iProperties of the stored document P2_2.ipt
Created: 2026-11-11
Part Number: P2
Material: Générique
Description: PART--DESC
Document SubType Name: Modeling
Designer: User
Density: 1 g/cm^3
Appearance: Par défaut
Author: User
Revision Number: NONE
## iProperties of the stored document NC3_1.ipt
Created: 2026-11-11
Part Number: NC3
Material: Générique
Description: PART--DESC
Document SubType Name: Modeling
Designer: User
Density: 1 g/cm^3
Appearance: Par défaut
Author: User
Revision Number: NONE
## iProperties of the stored document MURATA_DLP11SNXXXHL2_1.ipt
Created: 2026-11-11
Part Number: MURATA_DLP11SNXXXHL2
Material: Générique
Description: PART--DESC
Document SubType Name: Modeling
Designer: User
Density: 1 g/cm^3
Appearance: Par défaut
Author: User
Revision Number: NONE
## iProperties of the stored document Dielectric.ipt
Created: 2026-11-11
Part Number: Dielectric
Material: Générique
Description: PART--DESC
Document SubType Name: Modeling
Designer: User
Density: 1 g/cm^3
Appearance: Par défaut
Author: User
Revision Number: NONE
## iProperties of the stored document IN.ipt
Created: 2026-11-11
Part Number: IN
Material: Générique
Description: PART--DESC
Document SubType Name: Modeling
Designer: User
Density: 1 g/cm^3
Appearance: Par défaut
Author: User
Revision Number: NONE
## iProperties of the stored document 1_19.ipt
Created: 2026-11-11
Part Number: 1
Material: Générique
Description: PART--DESC
Document SubType Name: Modeling
Designer: User
Density: 1 g/cm^3
Appearance: Par défaut
Author: User
Revision Number: NONE
## iProperties of the stored document MECHANICAL PIN_5.ipt
Created: 2026-11-11
Part Number: MECHANICAL PIN
Material: Générique
Description: PART--DESC
Document SubType Name: Modeling
Designer: User
Density: 1 g/cm^3
Appearance: Par défaut
Author: User
Revision Number: NONE
## iProperties of the stored document 1_21.ipt
Created: 2026-11-11
Part Number: 1
Material: Générique
Description: PART--DESC
Document SubType Name: Modeling
Designer: User
Density: 1 g/cm^3
Appearance: Par défaut
Author: User
Revision Number: NONE
## iProperties of the stored document D2.ipt
Created: 2026-11-11
Part Number: D2
Material: Générique
Description: PART--DESC
Document SubType Name: Modeling
Designer: User
Density: 1 g/cm^3
Appearance: Par défaut
Author: User
Revision Number: NONE
## iProperties of the stored document MECHANICAL PIN_3.ipt
Created: 2026-11-11
Part Number: MECHANICAL PIN
Material: Générique
Description: PART--DESC
Document SubType Name: Modeling
Designer: User
Density: 1 g/cm^3
Appearance: Par défaut
Author: User
Revision Number: NONE
## iProperties of the stored document SDA_2.ipt
Created: 2026-11-11
Part Number: SDA
Material: Générique
Description: PART--DESC
Document SubType Name: Modeling
Designer: User
Density: 1 g/cm^3
Appearance: Par défaut
Author: User
Revision Number: NONE
## iProperties of the stored document SDA_1.ipt
Created: 2026-11-11
Part Number: SDA
Material: Générique
Description: PART--DESC
Document SubType Name: Modeling
Designer: User
Density: 1 g/cm^3
Appearance: Par défaut
Author: User
Revision Number: NONE
## iProperties of the stored document 14.ipt
Created: 2026-11-11
Part Number: 14
Material: Générique
Description: PART--DESC
Document SubType Name: Modeling
Designer: User
Density: 1 g/cm^3
Appearance: Par défaut
Author: User
Revision Number: NONE
## iProperties of the stored document 1_6.ipt
Created: 2026-11-11
Part Number: 1
Material: Générique
Description: PART--DESC
Document SubType Name: Modeling
Designer: User
Density: 1 g/cm^3
Appearance: Par défaut
Author: User
Revision Number: NONE
## iProperties of the stored document 2_18.ipt
Created: 2026-11-11
Part Number: 2
Material: Générique
Description: PART--DESC
Document SubType Name: Modeling
Designer: User
Density: 1 g/cm^3
Appearance: Par défaut
Author: User
Revision Number: NONE
## iProperties of the stored document 2_11.ipt
Created: 2026-11-11
Part Number: 2
Material: Générique
Description: PART--DESC
Document SubType Name: Modeling
Designer: User
Density: 1 g/cm^3
Appearance: Par défaut
Author: User
Revision Number: NONE
## iProperties of the stored document 1_8.ipt
Created: 2026-11-11
Part Number: 1
Material: Générique
Description: PART--DESC
Document SubType Name: Modeling
Designer: User